# Autodesk Inventor assembly: Assembly2
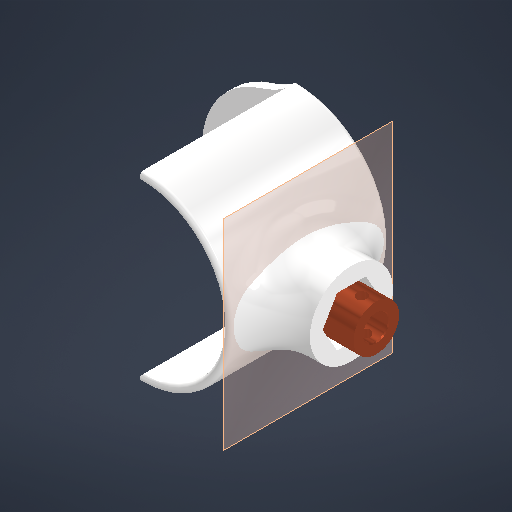
[picture p0: Inventor's stored thumbnail of the model, 512x512]
Saved by Autodesk Inventor 2026.2 (Build 302298000, 298)
## iProperties
Created: 2026-11-17
Part Number: Assembly2
Document SubType Name: Assembly
Designer: youse
Author: youse
## Documents named in this file (3)
- D:\modern control\Assembly2\Assembly2.iam
- D:\modern control\Assembly2\4mm 5mm 6mm Stainless Steel Hex Shaft Coupling.ipt
- D:\modern control\Assembly2\encoder case.ipt
## Components (2 placed, 2 different names)
1. 4mm 5mm 6mm Stainless Steel Hex Shaft Coupling:1 — Flush:1, Mate:1
2. encoder case:1 — Flush:1, Mate:1
## Relationships (2: Flush 1, Mate 1)
- Flush:1: 4mm 5mm 6mm Stainless Steel Hex Shaft Coupling:1 ↔ encoder case:1
- Mate:1: 4mm 5mm 6mm Stainless Steel Hex Shaft Coupling:1 ↔ encoder case:1
